# Autodesk Inventor assembly: robotfish_new_1
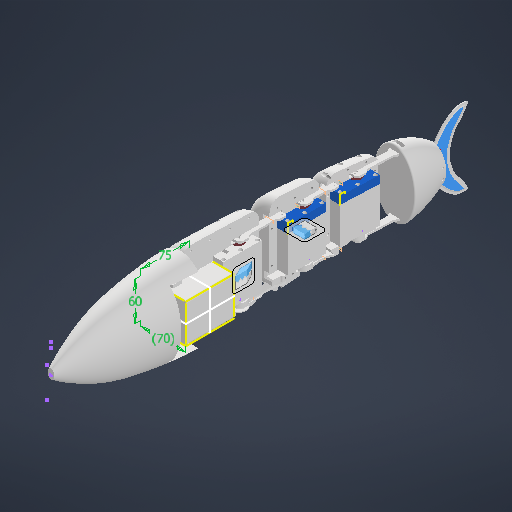
[picture p0: Inventor's stored thumbnail of the model, 512x512]
Saved by Autodesk Inventor 2027 (Build 310192060, 192F)
## iProperties
Created: 2026-08-25
Part Number: robotfish_new_1
Document SubType Name: Assembly
Designer: thita
Sending System: Autodesk Inventor 2027
Preprocessor: ST-DEVELOPER v20.1
Title: robotfish_newest_1.stp
Author: Laptop
## Documents named in this file (23)
- D:\Year2\đồ án tốt nghịp\đồ án tốt nghiệp v2\mới nhất v7\robotfish_final\Workgroups\NotInProject\robotfish_newest_1.iam
- D:\Year2\đồ án tốt nghịp\đồ án tốt nghiệp v2\mới nhất v7\robotfish_final\Workgroups\NotInProject\thanh lk.ipt
- D:\Year2\đồ án tốt nghịp\đồ án tốt nghiệp v2\mới nhất v7\robotfish_final\Workgroups\NotInProject\thanh lk 1.ipt
- D:\Year2\đồ án tốt nghịp\đồ án tốt nghiệp v2\mới nhất v7\robotfish_final\Workgroups\NotInProject\manh_tren_truc_2.ipt
- D:\Year2\đồ án tốt nghịp\đồ án tốt nghiệp v2\mới nhất v7\robotfish_final\Workgroups\NotInProject\manh_tren_truc_3.ipt
- D:\Year2\đồ án tốt nghịp\đồ án tốt nghiệp v2\mới nhất v7\robotfish_final\Workgroups\NotInProject\head.ipt
- D:\Year2\đồ án tốt nghịp\đồ án tốt nghiệp v2\mới nhất v7\robotfish_final\Workgroups\NotInProject\truc_khop_3_MIR.ipt
- D:\Year2\đồ án tốt nghịp\đồ án tốt nghiệp v2\mới nhất v7\robotfish_final\Workgroups\NotInProject\hop v3.iam
- D:\Year2\đồ án tốt nghịp\đồ án tốt nghiệp v2\mới nhất v7\robotfish_final\Workgroups\NotInProject\Assembly1.iam
- D:\Year2\đồ án tốt nghịp\đồ án tốt nghiệp v2\mới nhất v7\robotfish_final\Workgroups\NotInProject\thanh lk 2.ipt
- D:\Year2\đồ án tốt nghịp\đồ án tốt nghiệp v2\mới nhất v7\robotfish_final\Workgroups\NotInProject\thanh lk 4.ipt
- D:\Year2\đồ án tốt nghịp\đồ án tốt nghiệp v2\mới nhất v7\robotfish_final\Workgroups\NotInProject\thanhlk 3.ipt
- D:\Year2\đồ án tốt nghịp\đồ án tốt nghiệp v2\mới nhất v7\robotfish_final\Workgroups\NotInProject\thanhlk 5.ipt
- D:\Year2\đồ án tốt nghịp\đồ án tốt nghiệp v2\mới nhất v7\robotfish_final\Workgroups\NotInProject\vây đuôi phương án A.ipt
- D:\Year2\đồ án tốt nghịp\đồ án tốt nghiệp v2\mới nhất v7\robotfish_final\Workgroups\NotInProject\rigid_tailtail.ipt
- D:\Year2\đồ án tốt nghịp\đồ án tốt nghiệp v2\mới nhất v7\robotfish_final\Workgroups\NotInProject\segment1.ipt
- D:\Year2\đồ án tốt nghịp\đồ án tốt nghiệp v2\mới nhất v7\robotfish_final\Workgroups\NotInProject\segment3.ipt
- D:\Year2\đồ án tốt nghịp\đồ án tốt nghiệp v2\mới nhất v7\robotfish_final\Workgroups\NotInProject\segment2.ipt
- D:\Year2\đồ án tốt nghịp\đồ án tốt nghiệp v2\mới nhất v7\robotfish_final\Workgroups\NotInProject\segment1_left.ipt
- D:\Year2\đồ án tốt nghịp\đồ án tốt nghiệp v2\mới nhất v7\robotfish_final\Workgroups\NotInProject\segment2_left.ipt
- D:\Year2\đồ án tốt nghịp\đồ án tốt nghiệp v2\mới nhất v7\robotfish_final\Workgroups\NotInProject\segment3_left.ipt
- D:\Year2\đồ án tốt nghịp\đồ án tốt nghiệp v2\seg1 có pin\seg1\seg1.ipt
- D:\Downloads\1 nửa seg1\Workgroups\NotInProject\Pin 7.8Ah.ipt
## Components (24 placed, 22 different names)
1. thanh lk:1 — Rigid:2, Rotational:8
2. thanh lk 1:1 — Rotational:5, Rigid:4
3. manh_tren_truc_2:1 — Rigid:9, Rigid:10
4. manh_tren_truc_3:1 — Rigid:10, Rotational:9
5. head:1 — Rotational:9
6. truc_khop_3_MIR:1
7. hop v3:13 [sub-assembly] — Rigid:2, Rigid:3, Rotational:5
8. hop v3:14 [sub-assembly] — Rigid:4, Rigid:5, Rotational:10
9. Assembly1:17 [sub-assembly] — Rigid:6, Rotational:8
10. thanh lk 2:1 — Rotational:10, Rigid:11
11. thanh lk 4:2 — Rotational:7
12. thanhlk 3:2
13. thanhlk 5:2 — Rotational:11
14. vây đuôi phương án A:2 — Rigid:12
15. rigid_tailtail:3 — Rigid:11, Rigid:12
16. segment1:2
17. segment3:4 — Rigid:5, Rotational:11
18. segment2:2 — Rigid:3, Rotational:7
19. segment1_left:1
20. segment2_left:1
21. segment3_left:1
22. seg1:1 — Rigid:6, Rigid:7, Rigid:8, Rigid:9
23. truc_khop_3_MIR:2 — Rigid:8
24. Pin 7.8Ah:1 — Rigid:7
## Relationships (17: WeldJoint 11, RevoluteJoint 6)
- Rigid:2 [WeldJoint]: thanh lk:1 ↔ hop v3:13
- Rigid:3 [WeldJoint]: hop v3:13 ↔ segment2:2
- Rotational:5 [RevoluteJoint]: thanh lk 1:1 ↔ hop v3:13
- Rigid:4 [WeldJoint]: thanh lk 1:1 ↔ hop v3:14
- Rigid:5 [WeldJoint]: hop v3:14 ↔ segment3:4
- Rotational:7 [RevoluteJoint]: thanh lk 4:2 ↔ segment2:2
- Rigid:6 [WeldJoint]: Assembly1:17 ↔ seg1:1
- Rotational:8 [RevoluteJoint]: thanh lk:1 ↔ Assembly1:17
- Rigid:7 [WeldJoint]: seg1:1 ↔ Pin 7.8Ah:1
- Rigid:8 [WeldJoint]: seg1:1 ↔ truc_khop_3_MIR:2
- Rigid:9 [WeldJoint]: manh_tren_truc_2:1 ↔ seg1:1
- Rigid:10 [WeldJoint]: manh_tren_truc_2:1 ↔ manh_tren_truc_3:1
- Rotational:9 [RevoluteJoint]: manh_tren_truc_3:1 ↔ head:1
- Rotational:10 [RevoluteJoint]: hop v3:14 ↔ thanh lk 2:1
- Rotational:11 [RevoluteJoint]: thanhlk 5:2 ↔ segment3:4
- Rigid:11 [WeldJoint]: thanh lk 2:1 ↔ rigid_tailtail:3
- Rigid:12 [WeldJoint]: vây đuôi phương án A:2 ↔ rigid_tailtail:3
## Named parameters: Finish1_Area = 24.1011
note: some values were not read from the file. Shown as the stored number, unit unknown: "Finish1_Area".
